# Autodesk Inventor assembly: Assembly1
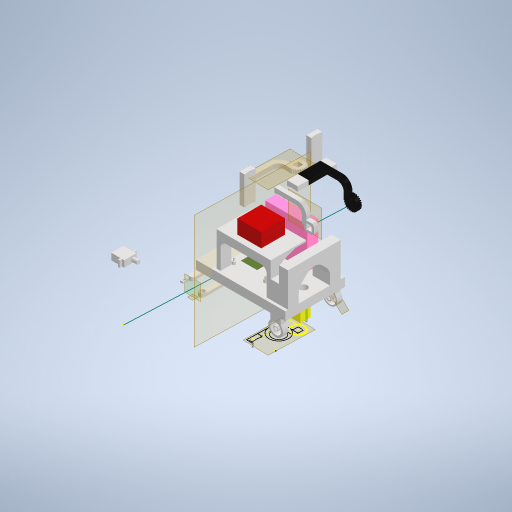
[picture p0: Inventor's stored thumbnail of the model, 512x512]
Saved by Autodesk Inventor 2023 (Build 270158000, 158)
## iProperties
Created: 2026-02-19
Part Number: Assembly1
Document SubType Name: Assembly
Designer: User
Author: User
## Documents named in this file (15)
- C:\Users\User\Documents\wro\Assembly1.iam
- C:\Users\User\Documents\wro\driver.ipt
- C:\Users\Public\Documents\Autodesk\Inventor 2023\Part1.ipt
- C:\Users\User\Documents\wro\battery holder.ipt
- C:\Users\User\Documents\wro\fan.ipt
- C:\Users\User\Documents\wro\chassis.ipt
- C:\Users\User\Documents\wro\servo.ipt
- C:\Users\User\Documents\wro\tire mounting.ipt
- C:\Users\User\Documents\wro\tire mounting_CPY.ipt
- C:\Users\Public\Documents\Autodesk\Inventor 2023\Part2.ipt
- C:\Users\User\Documents\wro\dc motor.ipt
- C:\Users\User\Documents\wro\dc support.ipt
- C:\Users\User\Documents\inventor wro\dcconnect.ipt
- C:\Users\User\Documents\wro\Part4.ipt
- C:\Users\User\Documents\wro\servoxx.ipt
## Components (16 placed, 14 different names)
1. driver:1 — Mate:3, Flush:6, Flush:7
2. Part1:1 — Mate:1, Flush:1, Flush:2, Flush:3, Mate:2, Flush:4, Flush:5
3. battery holder:1 — Mate:1, Flush:1, Flush:2
4. fan:1 — Flush:3, Mate:2, Flush:4
5. chassis:1 — Flush:5, Mate:3, Flush:6, Flush:7, Mate:9, Flush:14, Mate:10, Flush:15, Flush:16, Mate:11, Mate:12, Mate:13, Flush:17, Mate:14, Mate:15, Mate:16, Flush:20, Flush:21, Mate:22, Flush:23, Mate:23, Flush:24, Flush:25, Flush:26, Flush:28
6. servo:1
7. tire mounting_CPY:1 — Mate:9, Flush:14, Mate:12, Mate:13, Flush:17, Mate:14, Mate:15
8. tire mounting_CPY:2 — Mate:10, Flush:15, Flush:16, Mate:11
9. Part2:1
10. dc motor:1 — Mate:21, Flush:22
11. dc support:1 — Mate:16, Flush:20, Flush:21, Mate:21
12. dcconnect:1 — Flush:22
13. tire mounting:2 — Mate:23, Flush:24, Flush:25
14. tire mounting:4 — Mate:22, Flush:23, Flush:26, Flush:27
15. Part4:1 — Flush:27
16. servoxx:1 — Flush:28
## Relationships (34: Flush 20, Mate 14)
- Mate:1: Part1:1 ↔ battery holder:1
- Flush:1 (5 mm): Part1:1 ↔ battery holder:1
- Flush:2 (-6 mm): Part1:1 ↔ battery holder:1
- Flush:3 (13.75 mm): Part1:1 ↔ fan:1
- Mate:2 (5 mm): Part1:1 ↔ fan:1
- Flush:4 (-5 mm): Part1:1 ↔ fan:1
- Flush:5: Part1:1 ↔ chassis:1
- Mate:3: driver:1 ↔ chassis:1
- Flush:6 (10.5 mm): driver:1 ↔ chassis:1
- Flush:7 (-28 mm): driver:1 ↔ chassis:1
- Mate:9: chassis:1 ↔ tire mounting_CPY:1
- Flush:14: chassis:1 ↔ tire mounting_CPY:1
- Mate:10: chassis:1 ↔ tire mounting_CPY:2
- Flush:15: chassis:1 ↔ tire mounting_CPY:2
- Flush:16 (8.325 mm): chassis:1 ↔ tire mounting_CPY:2
- Mate:11: chassis:1 ↔ tire mounting_CPY:2
- Mate:12: chassis:1 ↔ tire mounting_CPY:1
- Mate:13: chassis:1 ↔ tire mounting_CPY:1
- Flush:17 (8.325 mm): chassis:1 ↔ tire mounting_CPY:1
- Mate:14: chassis:1 ↔ tire mounting_CPY:1
- Mate:15: chassis:1 ↔ tire mounting_CPY:1
- Mate:16: chassis:1 ↔ dc support:1
- Flush:20 (1 mm): chassis:1 ↔ dc support:1
- Flush:21 (-30 mm): chassis:1 ↔ dc support:1
- Mate:21: dc motor:1 ↔ dc support:1
- Flush:22: dc motor:1 ↔ dcconnect:1
- Mate:22: chassis:1 ↔ tire mounting:4
- Flush:23: chassis:1 ↔ tire mounting:4
- Mate:23: chassis:1 ↔ tire mounting:2
- Flush:24: chassis:1 ↔ tire mounting:2
- Flush:25 (-16 mm): chassis:1 ↔ tire mounting:2
- Flush:26 (-16 mm): chassis:1 ↔ tire mounting:4
- Flush:27: tire mounting:4 ↔ Part4:1
- Flush:28: chassis:1 ↔ servoxx:1
